# Autodesk Inventor assembly: Assembly1
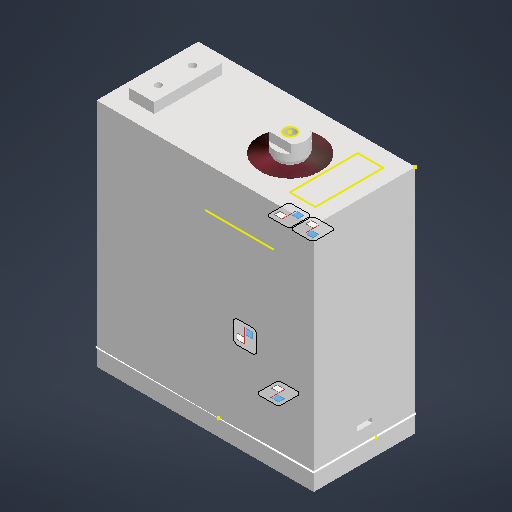
[picture p0: Inventor's stored thumbnail of the model, 512x512]
Saved by Autodesk Inventor 2027 (Build 310192060, 192F)
## iProperties
Created: 2026-08-12
Part Number: Assembly1
Document SubType Name: Assembly
Designer: Laptop
Author: Laptop
## iProperties of the stored document Servo_8120MG.iam
Company: none
Created: 2026-04-17
Part Number: Product3
Description: CATIA V5 STEP Exchange
Document SubType Name: Assembly
Designer: Laptop
Authority: none
Sending System: CATIA V5 STEP AP214 v3
Preprocessor: CATIA Version 5-6 Release 2023 SP4
Title: D:\Work it\EcoLid\V9_new Gen\Servo_8120MG.stp
Author: none
## iProperties of the stored document servo motor_8120MG.ipt
Created: 2026-08-12
Part Number: servo motor_8120MG
Material: Generic
Document SubType Name: Modeling
Designer: Laptop
Density: 1 g/cm^3
Appearance: Default
Author: Laptop
## iProperties of the stored document Servo horn v2.ipt
Created: 2026-08-12
Part Number: Servo horn
Material: Generic
Document SubType Name: Modeling
Designer: Laptop
Density: 1 g/cm^3
Appearance: Default
Author: Laptop
## Documents named in this file (11)
- D:\Downloads\Assembly1.iam
- **D:\Downloads\Assembly1.iam*LocalDocs*xAaaaavbaAaaaaaaaAaaaayyeQa*Servo_8120MG.iam
- D:\Year2\đồ án tốt nghịp\3d\cátrục (1).ipt
- D:\Year2\đồ án tốt nghịp\3d\cáhộp servo (2) (1).ipt
- D:\Year2\đồ án tốt nghịp\3d\cánap duoi servo (1) (2).ipt
- D:\Year2\đồ án tốt nghịp\3d\cánap tren servo_MIR_MIR.ipt
- D:\Year2\đồ án tốt nghịp\servo-motor_8120mg-1.snapshot.2\bạc đạn 8x16x5 2rs.ipt
- D:\Year2\đồ án tốt nghịp\servo-motor_8120mg-1.snapshot.2\phớt chặn dầu 8x18x5.ipt
- D:\Year2\đồ án tốt nghịp\servo-motor_8120mg-1.snapshot.2\Servo_8120MG.stp
- **D:\Downloads\Assembly1.iam*LocalDocs*xAaaaqedaAaaaaaaaAaaaap5mWf*Servo horn v2.ipt
- **D:\Downloads\Assembly1.iam*LocalDocs*xAaaaapbaAaaaaaaaAaaaqywvQd*servo motor_8120MG.ipt
## Components (7 placed, 7 different names)
1. Servo_8120MG:1 [sub-assembly] — Mate:3, Mate:4, Mate:6, Mate:7, Mate:8
2. cátrục (1):1 — Mate:6, Mate:7, Mate:9, Mate:10, Mate:14
3. cáhộp servo (2) (1):1 — Mate:1, Mate:2, Mate:3, Mate:8, Mate:11, Mate:12
4. cánap duoi servo (1) (2):1 — Mate:1, Mate:2, Mate:4
5. cánap tren servo_MIR_MIR:1 — Mate:11, Mate:12, Mate:13
6. bạc đạn 8x16x5 2rs:1 — Mate:9, Mate:10
7. phớt chặn dầu 8x18x5:1 — Mate:13, Mate:14
## Relationships (13: Mate 13)
- Mate:1: cáhộp servo (2) (1):1 ↔ cánap duoi servo (1) (2):1
- Mate:2 (0.01 mm): cáhộp servo (2) (1):1 ↔ cánap duoi servo (1) (2):1
- Mate:3: Servo_8120MG:1 ↔ cáhộp servo (2) (1):1
- Mate:4: Servo_8120MG:1 ↔ cánap duoi servo (1) (2):1
- Mate:6: Servo_8120MG:1 ↔ cátrục (1):1
- Mate:7: Servo_8120MG:1 ↔ cátrục (1):1
- Mate:8: Servo_8120MG:1 ↔ cáhộp servo (2) (1):1
- Mate:9: cátrục (1):1 ↔ bạc đạn 8x16x5 2rs:1
- Mate:10: cátrục (1):1 ↔ bạc đạn 8x16x5 2rs:1
- Mate:11: cáhộp servo (2) (1):1 ↔ cánap tren servo_MIR_MIR:1
- Mate:12: cáhộp servo (2) (1):1 ↔ cánap tren servo_MIR_MIR:1
- Mate:13: cánap tren servo_MIR_MIR:1 ↔ phớt chặn dầu 8x18x5:1
- Mate:14: cátrục (1):1 ↔ phớt chặn dầu 8x18x5:1
